# Autodesk Inventor assembly: Rotorschutz_Sandläufer_BG1
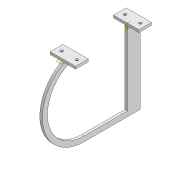
[picture p0: Inventor's stored thumbnail of the model, 180x180]
Saved by Autodesk Inventor 2020.1 (Build 241239000, 239)
## iProperties
Created: 2020-09-23
Part Number: Rotorschutz_Sandläufer_BG1
Document SubType Name: Assembly
Designer: s5chfeis
Author: s5chfeis
## Documents named in this file (3)
- Z:\Masterarbeit\CAD\CAD\Rotorschutz_Sandläufer_BG1.iam
- Z:\Masterarbeit\CAD\CAD\Rotorschutz_SL_BT1.ipt
- Z:\Masterarbeit\CAD\CAD\Rotorschutz_SL_BT3.ipt
## Components (3 placed, 2 different names)
1. Rotorschutz_SL_BT1:1 — Passend:1, Passend:2, Fluchtend:1, Passend:3, Passend:4, Fluchtend:2
2. Rotorschutz_SL_BT3:1 — Passend:1, Passend:2, Fluchtend:1
3. Rotorschutz_SL_BT3:2 — Passend:3, Passend:4, Fluchtend:2
## Relationships (6: Mate 4, Flush 2)
- Passend:1 [Mate]: Rotorschutz_SL_BT1:1 ↔ Rotorschutz_SL_BT3:1
- Passend:2 [Mate]: Rotorschutz_SL_BT1:1 ↔ Rotorschutz_SL_BT3:1
- Fluchtend:1 [Flush] (45 mm): Rotorschutz_SL_BT1:1 ↔ Rotorschutz_SL_BT3:1
- Passend:3 [Mate]: Rotorschutz_SL_BT1:1 ↔ Rotorschutz_SL_BT3:2
- Passend:4 [Mate]: Rotorschutz_SL_BT1:1 ↔ Rotorschutz_SL_BT3:2
- Fluchtend:2 [Flush] (-45 mm): Rotorschutz_SL_BT1:1 ↔ Rotorschutz_SL_BT3:2
